# Autodesk Inventor assembly: 1133 FP-800x1800x47
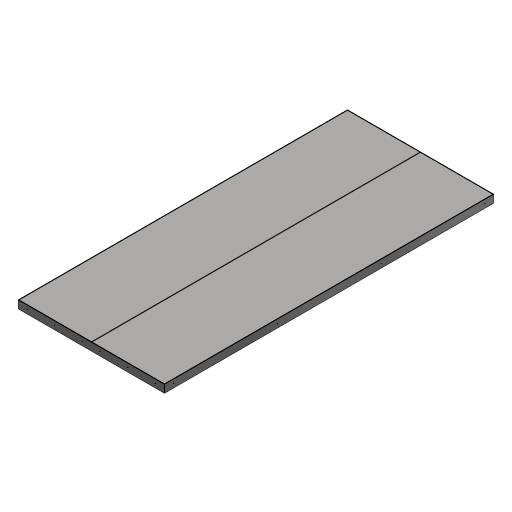
[picture p0: Inventor's stored thumbnail of the model, 512x512]
Saved by Autodesk Inventor 2024.3 (Build 283343000, 343)
## iProperties
RuleStatus: InUse
Created: 2019-06-24
Part Number: 1133 FP-800x1800x47
Material: Generisch
Document SubType Name: Assembly
Designer: MK
Mass: 27419.7 g
Surface Area: 69676.2 cm^2
Volume: 3569.06 cm^3
Density: 7.68259 g/cm^3
Description: Tür-Paneel
InventorSizerSetup: RP 1
Author: MK
## Documents named in this file (4)
- C:\Users\la\Documents\GitHub\Inventor_Sizer\C# Version\masters\RP\2T\1133 FP-800x1800x47.iam
- C:\Users\la\Documents\GitHub\Inventor_Sizer\C# Version\masters\RP\2T\1133 800x1800x47-Au.ipt
- C:\Users\la\Documents\GitHub\Inventor_Sizer\C# Version\masters\RP\2T\1133 800x1800x47-In.ipt
- C:\Users\la\Documents\GitHub\Inventor_Sizer\C# Version\masters\RP\1T\MFG1000000.ipt
## Components (6 placed, 3 different names)
1. 1133 800x1800x47-Au:1 — Mate:6, Mate:7, Mate:8, Mate:12, Mate:13, Mate:14
2. 1133 800x1800x47-In:1 — Mate:6, Mate:7, Mate:8
3. 1133 800x1800x47-In:2
4. MFG1000000:1 — Mate:12, Mate:13, Mate:14
5. MFG1000000:2
6. MFG1000000:3
## Component patterns: (2 elements, first: 1133 800x1800x47-In:1), (3 elements, first: MFG1000000:1)
## Relationships (6: Mate 6)
- Mate:6: 1133 800x1800x47-Au:1 ↔ 1133 800x1800x47-In:1
- Mate:7 (0.5 mm): 1133 800x1800x47-Au:1 ↔ 1133 800x1800x47-In:1
- Mate:8 (0.5 mm): 1133 800x1800x47-Au:1 ↔ 1133 800x1800x47-In:1
- Mate:12: 1133 800x1800x47-Au:1 ↔ MFG1000000:1
- Mate:13: 1133 800x1800x47-Au:1 ↔ MFG1000000:1
- Mate:14: 1133 800x1800x47-Au:1 ↔ MFG1000000:1
## Named parameters: Clearance = 0.5 mm, Width = 800 mm, InSplit = 2, InWidth = 398.5 mm, HandleCount = 3, HandleDir = 0, HandlePitch = 600 mm, HandleRef = 1800 mm, Length = 1800 mm, HandlePitchW = 0 mm, HandlePitchL = 600 mm, HandleCountL = 3, HandleCountW = 1
